# Autodesk Inventor assembly: robotfish_new_1
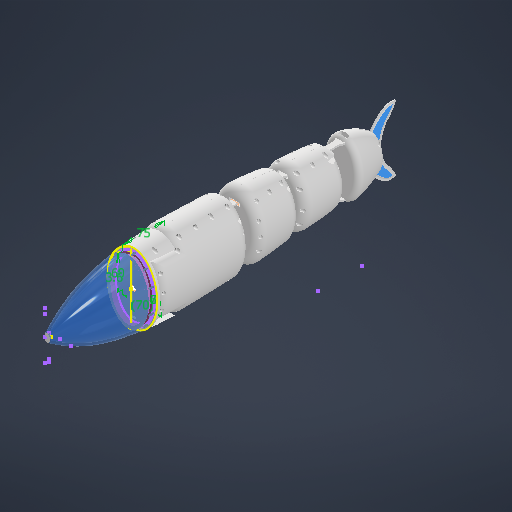
[picture p0: Inventor's stored thumbnail of the model, 512x512]
Saved by Autodesk Inventor 2027 (Build 310192060, 192F)
## iProperties
Created: 2026-08-25
Part Number: robotfish_new_1
Document SubType Name: Assembly
Designer: thita
Sending System: Autodesk Inventor 2027
Preprocessor: ST-DEVELOPER v20.1
Title: robotfish_newest_1.stp
Author: Laptop
## Documents named in this file (22)
- D:\Year2\đồ án tốt nghịp\đồ án tốt nghiệp v2\mới nhất v14\FULL_FISH\Workgroups\NotInProject\robotfish_newest_1.iam
- D:\Year2\đồ án tốt nghịp\đồ án tốt nghiệp v2\mới nhất v14\FULL_FISH\Workgroups\NotInProject\thanh lk.ipt
- D:\Year2\đồ án tốt nghịp\đồ án tốt nghiệp v2\mới nhất v14\FULL_FISH\Workgroups\NotInProject\thanh lk 1.ipt
- D:\Year2\đồ án tốt nghịp\đồ án tốt nghiệp v2\mới nhất v14\FULL_FISH\Workgroups\NotInProject\manh_tren_truc_2.ipt
- D:\Year2\đồ án tốt nghịp\đồ án tốt nghiệp v2\mới nhất v14\FULL_FISH\Workgroups\NotInProject\manh_tren_truc_3.ipt
- D:\Year2\đồ án tốt nghịp\đồ án tốt nghiệp v2\mới nhất v14\FULL_FISH\Workgroups\NotInProject\truc_khop_3_MIR.ipt
- D:\Year2\đồ án tốt nghịp\đồ án tốt nghiệp v2\mới nhất v14\FULL_FISH\Workgroups\NotInProject\hop v3.iam
- D:\Year2\đồ án tốt nghịp\đồ án tốt nghiệp v2\mới nhất v14\FULL_FISH\Workgroups\NotInProject\Assembly1.iam
- D:\Year2\đồ án tốt nghịp\đồ án tốt nghiệp v2\mới nhất v14\FULL_FISH\Workgroups\NotInProject\thanh lk 2.ipt
- D:\Year2\đồ án tốt nghịp\đồ án tốt nghiệp v2\mới nhất v14\FULL_FISH\Workgroups\NotInProject\thanh lk 4.ipt
- D:\Year2\đồ án tốt nghịp\đồ án tốt nghiệp v2\mới nhất v14\FULL_FISH\Workgroups\NotInProject\thanhlk 3.ipt
- D:\Year2\đồ án tốt nghịp\đồ án tốt nghiệp v2\mới nhất v14\FULL_FISH\Workgroups\NotInProject\thanhlk 5.ipt
- D:\Year2\đồ án tốt nghịp\đồ án tốt nghiệp v2\mới nhất v14\FULL_FISH\Workgroups\NotInProject\vây đuôi phương án A.ipt
- D:\Year2\đồ án tốt nghịp\đồ án tốt nghiệp v2\mới nhất v14\FULL_FISH\Workgroups\NotInProject\rigid_tailtail.ipt
- D:\Year2\đồ án tốt nghịp\đồ án tốt nghiệp v2\mới nhất v14\FULL_FISH\Workgroups\NotInProject\segment3.ipt
- D:\Year2\đồ án tốt nghịp\đồ án tốt nghiệp v2\mới nhất v14\FULL_FISH\Workgroups\NotInProject\Pin 7.8Ah.ipt
- D:\Year2\đồ án tốt nghịp\đồ án tốt nghiệp v2\mới nhất v14\FULL_FISH\Workgroups\NotInProject\dau_robot.iam
- D:\Year2\đồ án tốt nghịp\đồ án tốt nghiệp v2\mới nhất v14\FULL_FISH\Workgroups\NotInProject\seg2_TRAI.ipt
- D:\Year2\đồ án tốt nghịp\đồ án tốt nghiệp v2\mới nhất v14\FULL_FISH\Workgroups\NotInProject\seg1_TRAI.ipt
- D:\Year2\đồ án tốt nghịp\đồ án tốt nghiệp v2\mới nhất v14\FULL_FISH\Workgroups\NotInProject\seg3_TRAI.ipt
- D:\Year2\đồ án tốt nghịp\đồ án tốt nghiệp v2\mới nhất v14\FULL_FISH\Workgroups\NotInProject\seg2_PHAI.ipt
- D:\Year2\đồ án tốt nghịp\đồ án tốt nghiệp v2\mới nhất v14\STEP\STEP\seg1_PHAI\seg1_PHAI.ipt
## Components (22 placed, 21 different names)
1. thanh lk:1 — Rotational:12, Rigid:27, Rigid:28
2. thanh lk 1:1 — Rigid:29, Rotational:13, Rigid:30
3. manh_tren_truc_2:1 — Rigid:10
4. manh_tren_truc_3:1 — Rigid:10, Rigid:17
5. hop v3:13 [sub-assembly] — Rigid:27, Rigid:28, Rotational:13, Rigid:34
6. hop v3:14 [sub-assembly] — Rotational:10, Rigid:18, Rigid:29, Rigid:30
7. Assembly1:17 [sub-assembly] — Rotational:12
8. thanh lk 2:1 — Rotational:10, Rigid:31, Rigid:32
9. thanh lk 4:2
10. thanhlk 3:2
11. thanhlk 5:2 — Rotational:15
12. vây đuôi phương án A:2 — Rigid:35
13. rigid_tailtail:3 — Flush:5, Rigid:31, Rigid:32, Rigid:35
14. segment3:4 — Rigid:18, Rotational:15, Rigid:33
15. truc_khop_3_MIR:2 — Rigid:36
16. Pin 7.8Ah:1
17. dau_robot:1 [sub-assembly] — Rigid:17, Flush:2, Rigid:36
18. seg2_TRAI:1 — Rigid:37
19. seg1_TRAI:1 — Rigid:38
20. seg3_TRAI:1 — Rigid:33
21. seg2_PHAI:1 — Rigid:34, Rigid:37
22. seg1_PHAI:1 — Rigid:38
## Relationships (21: WeldJoint 15, RevoluteJoint 4, Flush 2)
- Rigid:10 [WeldJoint]: manh_tren_truc_2:1 ↔ manh_tren_truc_3:1
- Rotational:10 [RevoluteJoint]: hop v3:14 ↔ thanh lk 2:1
- Rigid:17 [WeldJoint]: manh_tren_truc_3:1 ↔ dau_robot:1
- Rigid:18 [WeldJoint]: hop v3:14 ↔ segment3:4
- Flush:2 (-30 mm): dau_robot:1
- Flush:5 (8 mm): rigid_tailtail:3
- Rotational:12 [RevoluteJoint]: thanh lk:1 ↔ Assembly1:17
- Rigid:27 [WeldJoint]: thanh lk:1 ↔ hop v3:13
- Rigid:28 [WeldJoint]: thanh lk:1 ↔ hop v3:13
- Rigid:29 [WeldJoint]: thanh lk 1:1 ↔ hop v3:14
- Rotational:13 [RevoluteJoint]: thanh lk 1:1 ↔ hop v3:13
- Rigid:30 [WeldJoint]: thanh lk 1:1 ↔ hop v3:14
- Rigid:31 [WeldJoint]: thanh lk 2:1 ↔ rigid_tailtail:3
- Rigid:32 [WeldJoint]: thanh lk 2:1 ↔ rigid_tailtail:3
- Rotational:15 [RevoluteJoint]: thanhlk 5:2 ↔ segment3:4
- Rigid:33 [WeldJoint]: segment3:4 ↔ seg3_TRAI:1
- Rigid:34 [WeldJoint]: hop v3:13 ↔ seg2_PHAI:1
- Rigid:35 [WeldJoint] (-5 mm): vây đuôi phương án A:2 ↔ rigid_tailtail:3
- Rigid:36 [WeldJoint]: truc_khop_3_MIR:2 ↔ dau_robot:1
- Rigid:37 [WeldJoint]: seg2_TRAI:1 ↔ seg2_PHAI:1
- Rigid:38 [WeldJoint]: seg1_TRAI:1 ↔ seg1_PHAI:1
## Named parameters: Finish1_Area = 24.1011
note: some values were not read from the file. Shown as the stored number, unit unknown: "Finish1_Area".
